# Autodesk Inventor assembly: C15K110A1CUM5N
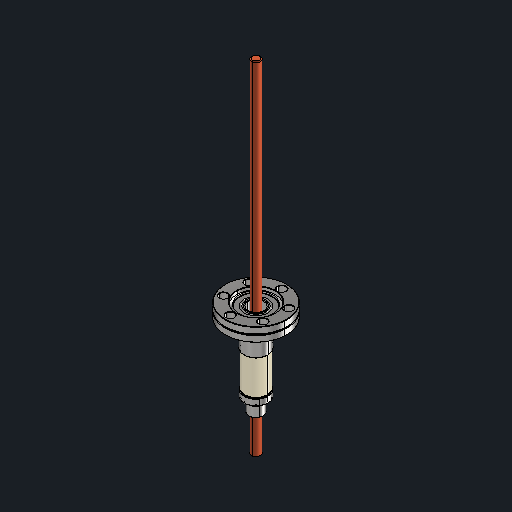
[picture p0: Inventor's stored thumbnail of the model, 512x512]
Saved by Autodesk Inventor 2027.1 (Build 311270010, 270A)
## iProperties
Created: 2013-12-06
Part Number: C15K110A1CUM5N
Document SubType Name: Assembly
Designer: kuzmin
Mass: 86.3854 g
Surface Area: 113.384 cm^2
Volume: 12.0109 cm^3
Density: 7.19226 g/cm^3
Sending System: SolidWorks 2010
Major Version: 6.0
Minor Version: 0.0
Format Version: 0.0
Product Id: SolidWorks 2010
Author: kuzmin
## Documents named in this file (9)
- C:\Users\queezz\Dropbox\Drawings\pihti-cad\Miura-membrane-experiments\components\C15K110A1CUM5N.iam
- C:\Users\queezz\Dropbox\Drawings\pihti-cad\Miura-membrane-experiments\components\C15K110A1CUM5N.ipt
- C:\Users\queezz\Dropbox\Drawings\pihti-cad\Miura-membrane-experiments\components\C15K110A1CUM5N_1.ipt
- C:\Users\queezz\Dropbox\Drawings\pihti-cad\Miura-membrane-experiments\components\C15K110A1CUM5N_2.ipt
- C:\Users\queezz\Dropbox\Drawings\pihti-cad\Miura-membrane-experiments\components\C15K110A1CUM5N_3.ipt
- C:\Users\queezz\Dropbox\Drawings\pihti-cad\Miura-membrane-experiments\components\C15K110A1CUM5N_4.ipt
- C:\Users\queezz\Dropbox\Drawings\pihti-cad\Miura-membrane-experiments\components\C15K110A1CUM5N_5.ipt
- C:\Users\queezz\Dropbox\Drawings\pihti-cad\Miura-membrane-experiments\components\C15K110A1CUM5N_6.ipt
- C:\Users\queezz\Dropbox\Drawings\pihti-cad\Miura-membrane-experiments\components\C15K110A1CUM5N_7.ipt
## Components (8 placed, 8 different names)
1. C15K110A1CUM5N_1:1 — Rotational:1
2. C15K110A1CUM5N_2:1
3. C15K110A1CUM5N_3:1
4. C15K110A1CUM5N_4:1
5. C15K110A1CUM5N_5:1 — Rotational:2
6. C15K110A1CUM5N_6:1 — Rotational:2
7. C15K110A1CUM5N_7:1
8. C15K110A1CUM5N_8:1 — Rotational:1
## Relationships (2: RevoluteJoint 2)
- Rotational:1 [RevoluteJoint]: C15K110A1CUM5N_1:1 ↔ C15K110A1CUM5N_8:1
- Rotational:2 [RevoluteJoint]: C15K110A1CUM5N_5:1 ↔ C15K110A1CUM5N_6:1
